# Autodesk Inventor assembly: Stand_Assembly
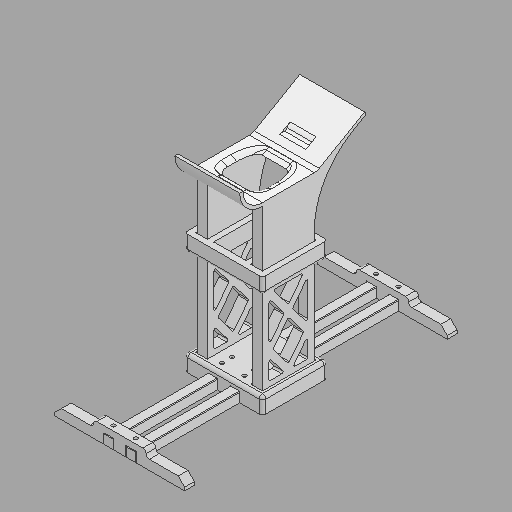
[picture p0: Inventor's stored thumbnail of the model, 512x512]
Saved by Autodesk Inventor 2025 (Build 290162000, 162)
## iProperties
Created: 2024-11-18
Part Number: Stand_Assembly
Document SubType Name: Assembly
Designer: OSB
Sending System: Autodesk Inventor 2021
Preprocessor: unknown
Minimum Resolution: 0.01
Sent Units: Millimeter
Translation Standard: IGES 5.3
Model Creation Time: 2020-07-07
Title: S500 Frame
Author: OSB
## Documents named in this file (6)
- C:\Users\OSB\Desktop\SB\1.Projects\4_2\캡스톤 디자인(2)\Modeling\Implementation_Design\Ver_002\Stand_Assembly.iam
- C:\Users\OSB\Desktop\SB\1.Projects\4_2\캡스톤 디자인(2)\Modeling\Implementation_Design\Ver_002\Stand_Bottom.ipt
- C:\Users\OSB\Desktop\SB\1.Projects\4_2\캡스톤 디자인(2)\Modeling\Implementation_Design\Ver_002\Stand_Bottom_Bar.ipt
- C:\Users\OSB\Desktop\SB\1.Projects\4_2\캡스톤 디자인(2)\Modeling\Implementation_Design\Ver_002\Stand_Bottom_Clamp.ipt
- C:\Users\OSB\Desktop\SB\1.Projects\4_2\캡스톤 디자인(2)\Modeling\Implementation_Design\Ver_002\Stand_Middle.ipt
- C:\Users\OSB\Desktop\SB\1.Projects\4_2\캡스톤 디자인(2)\Modeling\Implementation_Design\Ver_002\Stand_Top.ipt
## Components (9 placed, 5 different names)
1. Stand_Bottom:1 — 강체:2, 강체:3, 강체:4, 강체:5, 메이트:1, 메이트:2, 메이트:3
2. Stand_Bottom_Bar:1 — 강체:5
3. Stand_Bottom_Bar:2 — 강체:2, 강체:6
4. Stand_Bottom_Bar:3 — 강체:3
5. Stand_Bottom_Bar:4 — 강체:4, 강체:7
6. Stand_Bottom_Clamp:1 — 강체:6
7. Stand_Bottom_Clamp:2 — 강체:7
8. Stand_Middle:1 — 메이트:1, 메이트:2, 메이트:3, 메이트:4, 메이트:5, 메이트:6
9. Stand_Top:1 — 메이트:4, 메이트:5, 메이트:6
## Relationships (12: WeldJoint 6, Mate 6)
- 강체:2 [WeldJoint] (0.5 mm): Stand_Bottom:1 ↔ Stand_Bottom_Bar:2
- 강체:3 [WeldJoint] (0.5 mm): Stand_Bottom:1 ↔ Stand_Bottom_Bar:3
- 강체:4 [WeldJoint] (0.5 mm): Stand_Bottom:1 ↔ Stand_Bottom_Bar:4
- 강체:5 [WeldJoint] (0.5 mm): Stand_Bottom:1 ↔ Stand_Bottom_Bar:1
- 강체:6 [WeldJoint] (-0.5 mm): Stand_Bottom_Bar:2 ↔ Stand_Bottom_Clamp:1
- 강체:7 [WeldJoint] (-0.5 mm): Stand_Bottom_Bar:4 ↔ Stand_Bottom_Clamp:2
- 메이트:1 [Mate]: Stand_Bottom:1 ↔ Stand_Middle:1
- 메이트:2 [Mate] (0.5 mm): Stand_Bottom:1 ↔ Stand_Middle:1
- 메이트:3 [Mate] (0.5 mm): Stand_Bottom:1 ↔ Stand_Middle:1
- 메이트:4 [Mate]: Stand_Middle:1 ↔ Stand_Top:1
- 메이트:5 [Mate] (0.5 mm): Stand_Middle:1 ↔ Stand_Top:1
- 메이트:6 [Mate] (0.5 mm): Stand_Middle:1 ↔ Stand_Top:1
